# Autodesk Inventor assembly: HeadAssembly
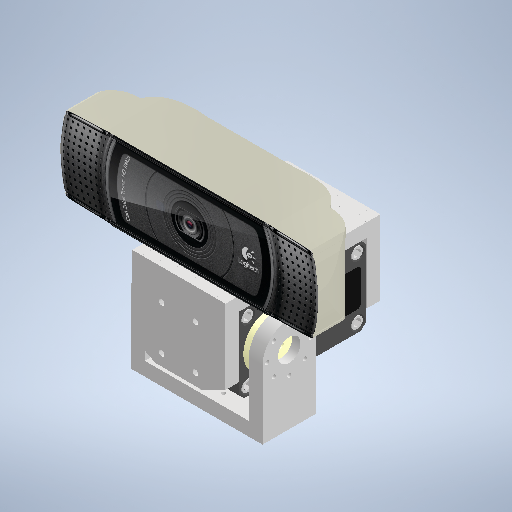
[picture p0: Inventor's stored thumbnail of the model, 512x512]
Saved by Autodesk Inventor 2025.2 (Build 292293000, 293)
## iProperties
Created: 2025-06-28
Part Number: HeadAssembly
Document SubType Name: Assembly
Designer: ricoa
Author: ricoa
## Documents named in this file (8)
- C:\Users\ricoa\OneDrive\Desktop\PROYEK AKHIR\project_pororo\Head\HeadAssembly.iam
- C:\Users\ricoa\OneDrive\Desktop\PROYEK AKHIR\project_pororo\Head\camera c920.ipt
- C:\Users\ricoa\OneDrive\Desktop\PROYEK AKHIR\project_pororo\XM430-W350-R\XM430-W350-R\XM430-W350-R.iam
- C:\Users\ricoa\OneDrive\Desktop\PROYEK AKHIR\project_pororo\Head\NeckFront.ipt
- C:\Users\ricoa\OneDrive\Desktop\PROYEK AKHIR\project_pororo\Head\NeckTop.ipt
- C:\Users\ricoa\OneDrive\Desktop\PROYEK AKHIR\project_pororo\Head\NeckSide2.ipt
- C:\Users\ricoa\OneDrive\Desktop\PROYEK AKHIR\project_pororo\Head\NeckConnectSide.ipt
- C:\Users\ricoa\OneDrive\Desktop\PROYEK AKHIR\project_pororo\Head\NeckConnectBot.ipt
## Components (8 placed, 7 different names)
1. camera c920:1 — Mate:1, Mate:2, Mate:3
2. XM430-W350-R:1 [sub-assembly] — Flush:1, Flush:2, Flush:3, Flush:4, Mate:4, Mate:5, Mate:11
3. NeckFront:1 — Flush:1, Mate:9, Mate:10
4. NeckTop:1 — Flush:2, Mate:1, Mate:2, Mate:3, Mate:9, Mate:10, Mate:11, Mate:12, Mate:13
5. NeckSide2:1 — Flush:3, Mate:12, Mate:13
6. NeckConnectSide:1 — Flush:4, Mate:6, Mate:7
7. NeckConnectSide:2 — Mate:4, Mate:5, Flush:5, Mate:8
8. NeckConnectBot:1 — Flush:5, Mate:6, Mate:7, Mate:8
## Relationships (18: Mate 13, Flush 5)
- Flush:1: XM430-W350-R:1 ↔ NeckFront:1
- Flush:2: XM430-W350-R:1 ↔ NeckTop:1
- Flush:3: XM430-W350-R:1 ↔ NeckSide2:1
- Mate:1: camera c920:1 ↔ NeckTop:1
- Mate:2: camera c920:1 ↔ NeckTop:1
- Mate:3: camera c920:1 ↔ NeckTop:1
- Flush:4: XM430-W350-R:1 ↔ NeckConnectSide:1
- Mate:4: XM430-W350-R:1 ↔ NeckConnectSide:2
- Mate:5: XM430-W350-R:1 ↔ NeckConnectSide:2
- Flush:5: NeckConnectSide:2 ↔ NeckConnectBot:1
- Mate:6: NeckConnectSide:1 ↔ NeckConnectBot:1
- Mate:7: NeckConnectSide:1 ↔ NeckConnectBot:1
- Mate:8: NeckConnectSide:2 ↔ NeckConnectBot:1
- Mate:9: NeckFront:1 ↔ NeckTop:1
- Mate:10: NeckFront:1 ↔ NeckTop:1
- Mate:11: XM430-W350-R:1 ↔ NeckTop:1
- Mate:12: NeckTop:1 ↔ NeckSide2:1
- Mate:13: NeckTop:1 ↔ NeckSide2:1
